# Autodesk Inventor assembly: payload sub assembly
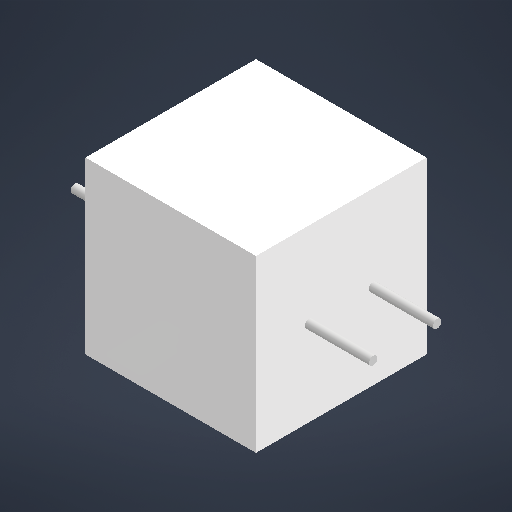
[picture p0: Inventor's stored thumbnail of the model, 512x512]
Saved by Autodesk Inventor 2026.1 (Build 301233000, 233)
## iProperties
Created: 2025-11-11
Part Number: payload sub assembly
Document SubType Name: Assembly
Designer: shiva
Author: shiva
## Documents named in this file (3)
- D:\assignments\SEM 1\CAM\RPM\bigger version\inner sub assembly\payload sub assembly.iam
- D:\assignments\SEM 1\CAM\RPM\bigger version\payload sub assembly\space.ipt
- D:\assignments\SEM 1\CAM\RPM\bigger version\payload sub assembly\pin.ipt
## Components (3 placed, 2 different names)
1. space:1 — Mate:1, Mate:2, Flush:1
2. pin:1 — Mate:1, Flush:2
3. pin:2 — Mate:2, Flush:1, Flush:2
## Relationships (4: Mate 2, Flush 2)
- Mate:1: space:1 ↔ pin:1
- Mate:2: space:1 ↔ pin:2
- Flush:1 (75 mm): space:1 ↔ pin:2
- Flush:2: pin:1 ↔ pin:2
